# Autodesk Inventor assembly: SPE8V1 Estructura (soldadura)
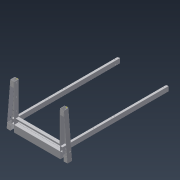
[picture p0: Inventor's stored thumbnail of the model, 180x180]
Saved by Autodesk Inventor 2021.2 (Build 252289000, 289)
## iProperties
Created: 2026-10-27
Part Number: SPE8V1 Estructura (soldadura)
Document SubType Name: Assembly
Designer: Tecnica
Author: Tecnica
## Documents named in this file (11)
- C:\Users\Tecnica\OneDrive\Documentos\Mecanica\Soporte-Paciente-Espinografia\Workspace\SPE8V1 Estructura (soldadura).iam
- C:\Users\Tecnica\OneDrive\Documentos\Mecanica\Soporte-Paciente-Espinografia\Workspace\SP15V1 Tubo 40x80x1825mm.ipt
- C:\Users\Tecnica\OneDrive\Documentos\Mecanica\Soporte-Paciente-Espinografia\Workspace\SP13V1 Tubo 40x80x94mm.ipt
- C:\Users\Tecnica\OneDrive\Documentos\Mecanica\Soporte-Paciente-Espinografia\Workspace\SP17V1 Cobertora Derecha.ipt
- C:\Users\Tecnica\OneDrive\Documentos\Mecanica\Soporte-Paciente-Espinografia\Workspace\SP18V1 Cobertora Izquierda.ipt
- C:\Users\Tecnica\OneDrive\Documentos\Mecanica\Soporte-Paciente-Espinografia\Workspace\SP12V1 Tubo 80x120x790mm.ipt
- C:\Users\Tecnica\OneDrive\Documentos\Mecanica\Soporte-Paciente-Espinografia\Workspace\SP16V1 Buje Pedal.ipt
- C:\Users\Tecnica\OneDrive\Documentos\Mecanica\Soporte-Paciente-Espinografia\Workspace\SP14V1 Tubo 40x80x1825mm.ipt
- C:\Users\Tecnica\OneDrive\Documentos\Mecanica\Soporte-Paciente-Espinografia\Workspace\SP19V1 Tope Base.ipt
- C:\Users\Tecnica\OneDrive\Documentos\Mecanica\Soporte-Paciente-Espinografia\Workspace\SP20V1 Cobertor Freno.ipt
- C:\Users\Tecnica\OneDrive\Documentos\Mecanica\Soporte-Paciente-Espinografia\Workspace\SP21V1 Chapa Guia.ipt
## Components (15 placed, 10 different names)
1. SP12V1 Tubo 80x120x790mm:1
2. SP13V1 Tubo 40x80x94mm:1
3. SP13V1 Tubo 40x80x94mm:2
4. SP13V1 Tubo 40x80x94mm:3
5. SP13V1 Tubo 40x80x94mm:4
6. SP14V1 Tubo 40x80x1825mm:1
7. SP15V1 Tubo 40x80x1825mm:1
8. SP16V1 Buje Pedal:1
9. SP16V1 Buje Pedal:2
10. SP17V1 Cobertora Derecha:1
11. SP18V1 Cobertora Izquierda:1
12. SP19V1 Tope Base:1
13. SP20V1 Cobertor Freno:1
14. SP21V1 Chapa Guia:1
15. SP21V1 Chapa Guia:2
## Relationships (38: Mate 27, Flush 11)
- [Flush]: SP13V1 Tubo 40x80x94mm:1 ↔ SP17V1 Cobertora Derecha:1
- [Mate] (0.5 mm): SP13V1 Tubo 40x80x94mm:1 ↔ SP17V1 Cobertora Derecha:1
- [Flush]: SP15V1 Tubo 40x80x1825mm:1 ↔ SP17V1 Cobertora Derecha:1
- [Mate]: SP13V1 Tubo 40x80x94mm:2 ↔ SP17V1 Cobertora Derecha:1
- [Mate]: SP13V1 Tubo 40x80x94mm:2 ↔ SP17V1 Cobertora Derecha:1
- [Flush]: SP17V1 Cobertora Derecha:1 ↔ SP18V1 Cobertora Izquierda:1
- [Mate]: SP13V1 Tubo 40x80x94mm:1 ↔ SP17V1 Cobertora Derecha:1
- [Mate]: SP13V1 Tubo 40x80x94mm:3 ↔ SP18V1 Cobertora Izquierda:1
- [Mate]: SP13V1 Tubo 40x80x94mm:3 ↔ SP18V1 Cobertora Izquierda:1
- [Flush]: SP12V1 Tubo 80x120x790mm:1 ↔ SP18V1 Cobertora Izquierda:1
- [Mate]: SP12V1 Tubo 80x120x790mm:1 ↔ SP15V1 Tubo 40x80x1825mm:1
- [Mate]: SP15V1 Tubo 40x80x1825mm:1 ↔ SP17V1 Cobertora Derecha:1
- [Flush]: SP12V1 Tubo 80x120x790mm:1 ↔ SP17V1 Cobertora Derecha:1
- [Flush]: SP12V1 Tubo 80x120x790mm:1 ↔ SP18V1 Cobertora Izquierda:1
- [Mate]: SP13V1 Tubo 40x80x94mm:3 ↔ SP18V1 Cobertora Izquierda:1
- [Mate]: SP13V1 Tubo 40x80x94mm:2 ↔ SP17V1 Cobertora Derecha:1
- [Mate]: SP16V1 Buje Pedal:1 ↔ SP16V1 Buje Pedal:2
- [Flush]: SP16V1 Buje Pedal:2 ↔ SP18V1 Cobertora Izquierda:1
- [Flush]: SP16V1 Buje Pedal:1 ↔ SP17V1 Cobertora Derecha:1
- [Mate]: SP16V1 Buje Pedal:1 ↔ SP17V1 Cobertora Derecha:1
- [Mate] (0.5 mm): SP13V1 Tubo 40x80x94mm:4 ↔ SP18V1 Cobertora Izquierda:1
- [Mate]: SP13V1 Tubo 40x80x94mm:4 ↔ SP18V1 Cobertora Izquierda:1
- [Mate]: SP17V1 Cobertora Derecha:1 ↔ SP19V1 Tope Base:1
- [Flush]: SP17V1 Cobertora Derecha:1 ↔ SP19V1 Tope Base:1
- [Flush]: SP12V1 Tubo 80x120x790mm:1 ↔ SP20V1 Cobertor Freno:1
- [Mate]: SP12V1 Tubo 80x120x790mm:1 ↔ SP20V1 Cobertor Freno:1
- [Mate]: SP19V1 Tope Base:1 ↔ SP20V1 Cobertor Freno:1
- [Mate]: SP12V1 Tubo 80x120x790mm:1 ↔ SP14V1 Tubo 40x80x1825mm:1
- [Mate]: SP14V1 Tubo 40x80x1825mm:1 ↔ SP18V1 Cobertora Izquierda:1
- [Flush]: SP14V1 Tubo 40x80x1825mm:1 ↔ SP18V1 Cobertora Izquierda:1
- [Mate]: SP12V1 Tubo 80x120x790mm:1 ↔ SP18V1 Cobertora Izquierda:1
- [Mate]: SP12V1 Tubo 80x120x790mm:1 ↔ SP17V1 Cobertora Derecha:1
- [Mate]: SP15V1 Tubo 40x80x1825mm:1 ↔ SP21V1 Chapa Guia:2
- [Mate]: SP14V1 Tubo 40x80x1825mm:1 ↔ SP21V1 Chapa Guia:1
- [Mate]: SP14V1 Tubo 40x80x1825mm:1 ↔ SP21V1 Chapa Guia:1
- [Mate]: SP14V1 Tubo 40x80x1825mm:1 ↔ SP21V1 Chapa Guia:1
- [Mate]: SP15V1 Tubo 40x80x1825mm:1 ↔ SP21V1 Chapa Guia:2
- [Mate]: SP15V1 Tubo 40x80x1825mm:1 ↔ SP21V1 Chapa Guia:2
## Named parameters: d0_d33 = 0 mm, d1_d34 = 0.5 mm
